# Autodesk Inventor assembly: Moving_Finger
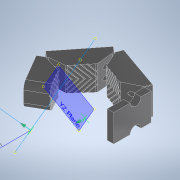
[picture p0: Inventor's stored thumbnail of the model, 180x180]
Saved by Autodesk Inventor 2021 (Build 250183000, 183)
## iProperties
Created: 2026-04-08
Part Number: Moving_Finger
Document SubType Name: Assembly
Designer: Admin
Mass: 43.131 g
Surface Area: 150.108 cm^2
Volume: 43.131 cm^3
Density: 1 g/cm^3
Author: Admin
## Documents named in this file (5)
- C:\Users\Admin\Desktop\Università\MAGISTRALE\Y2_S2\SOFT ROBOTIC\Project\Model\V10\Finger\Moving_Finger.iam
- C:\Users\Admin\Desktop\Università\MAGISTRALE\Y2_S2\SOFT ROBOTIC\Project\Model\V10\Finger\Finger_1.ipt
- C:\Users\Admin\Desktop\Università\MAGISTRALE\Y2_S2\SOFT ROBOTIC\Project\Model\V10\Finger\Finger_2.ipt
- C:\Users\Admin\Desktop\Università\MAGISTRALE\Y2_S2\SOFT ROBOTIC\Project\Model\V10\Finger\Finger_3.ipt
- C:\Users\Admin\Desktop\Università\MAGISTRALE\Y2_S2\SOFT ROBOTIC\Project\Model\V10\Finger\Finger_4.ipt
## Components (4 placed, 4 different names)
1. Finger_1:1 — Mate:3, Flush:1, Flush:2, Flush:4, Angle:1
2. Finger_2:1 — Mate:2, Mate:3, Flush:1, Angle:1, Angle:2
3. Finger_3:1 — Mate:1, Mate:2, Flush:2, Flush:3, Angle:2, Angle:3
4. Finger_4:1 — Mate:1, Flush:3, Angle:3, Flush:5, Mate:4
## Relationships (12: Flush 5, Mate 4, Angle 3)
- Mate:1: Finger_3:1 ↔ Finger_4:1
- Mate:2: Finger_2:1 ↔ Finger_3:1
- Mate:3: Finger_1:1 ↔ Finger_2:1
- Flush:1: Finger_1:1 ↔ Finger_2:1
- Flush:2: Finger_1:1 ↔ Finger_3:1
- Flush:3: Finger_3:1 ↔ Finger_4:1
- Flush:4: Finger_1:1
- Angle:1 (70 deg): Finger_1:1 ↔ Finger_2:1
- Angle:2 (70 deg): Finger_2:1 ↔ Finger_3:1
- Angle:3 (-70 deg): Finger_3:1 ↔ Finger_4:1
- Flush:5: Finger_4:1
- Mate:4: Finger_4:1
